# Autodesk Inventor assembly: Echelle grating support - four plates, three part types
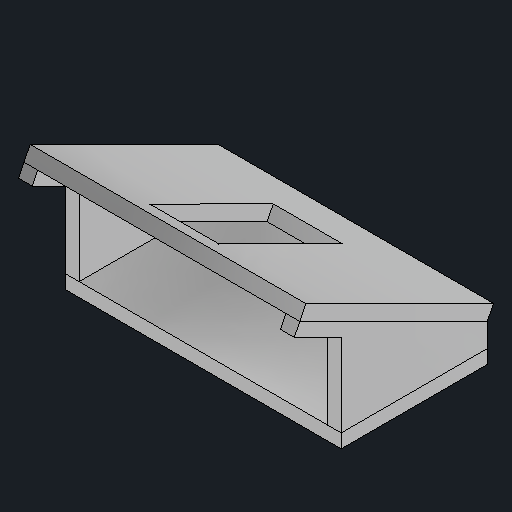
[picture p0: Inventor's stored thumbnail of the model, 512x512]
Saved by Autodesk Inventor 2027.1 (Build 311270010, 270A)
## iProperties
Created: 2026-11-21
Part Number: Echelle grating support - four plates, three part types
Description: Echelle grating support - four plates, three part types; photo-based dimensional mockup, verify before fabrication
Document SubType Name: Assembly
Designer: queezz
Author: queezz
## Documents named in this file (4)
- C:\Users\queezz\Dropbox\Drawings\pihti-cad\Echelle\echelle-grating-support.iam
- C:\Users\queezz\Dropbox\Drawings\pihti-cad\Echelle\echelle-support-base.ipt
- C:\Users\queezz\Dropbox\Drawings\pihti-cad\Echelle\echelle-support-roof.ipt
- C:\Users\queezz\Dropbox\Drawings\pihti-cad\Echelle\echelle-support-side.ipt
## Components (4 placed, 4 different names)
1. Upright front bottom plate
2. Roof plate
3. Left side plate
4. Right side plate — Right side width, Right side depth, Right side elevation
## Relationships (3: Flush 3)
- Right side width [Flush] (-190 mm): Right side plate
- Right side depth [Flush]: Right side plate
- Right side elevation [Flush]: Right side plate
## Named parameters: SupportWidth = 200 mm, StockThickness = 10 mm, SupportHeight = 140 mm, RoofAngle = 26.5 deg, RoofFoot = 38.36 mm, ArmHeight = 106 mm, ArmRoot = 70 mm, ArmTip = 87 mm, WindowWidth = 50 mm, WindowLength = 100 mm, WindowCentreHeight = 75 mm, BaseDepth = 10 mm, RoofEndHeight = 131.54987 mm, RoofEndDepth = 103.94834 mm
